# Autodesk Inventor assembly: sub
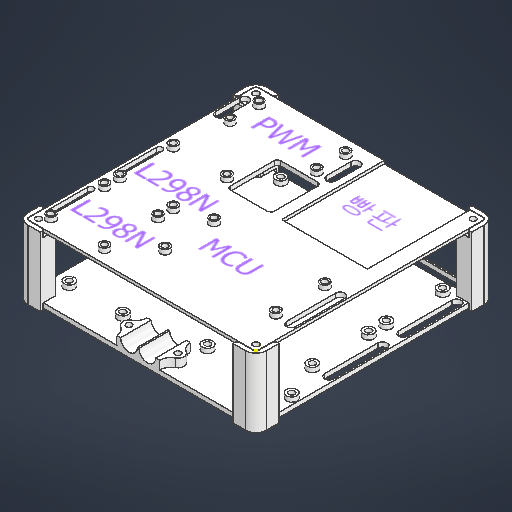
[picture p0: Inventor's stored thumbnail of the model, 512x512]
Saved by Autodesk Inventor 2026.2 (Build 302298010, 298A)
## iProperties
Created: 2026-04-29
Part Number: sub
Document SubType Name: Assembly
Designer: work
Author: work
## Documents named in this file (4)
- C:\Users\work\Desktop\ARD_v1\ARD_hardware\RA_Project\Substrate\sub.iam
- C:\Users\work\Desktop\ARD_v1\ARD_hardware\RA_Project\Substrate\Pillar.ipt
- C:\Users\work\Desktop\ARD_v1\ARD_hardware\RA_Project\Substrate\Power board.ipt
- C:\Users\work\Desktop\ARD_v1\ARD_hardware\RA_Project\Substrate\Control Board.ipt
## Components (6 placed, 3 different names)
1. Pillar:1 — 메이트:1, 메이트:2, 각도:1
2. Power board:1 — 메이트:1, 메이트:2, 각도:1, 메이트:3, 메이트:4, 메이트:5, 메이트:6, 메이트:7, 메이트:8, 각도:2, 각도:3, 각도:4
3. Control Board:1 — 메이트:9, 메이트:10, 메이트:11
4. Pillar:2 — 메이트:5, 메이트:6, 각도:3
5. Pillar:3 — 메이트:3, 메이트:8, 각도:4, 메이트:10, 메이트:11
6. Pillar:4 — 메이트:4, 메이트:7, 각도:2, 메이트:9
## Relationships (15: Mate 11, Angle 4)
- 메이트:1 [Mate]: Pillar:1 ↔ Power board:1
- 메이트:2 [Mate]: Pillar:1 ↔ Power board:1
- 각도:1 [Angle] (0 deg): Pillar:1 ↔ Power board:1
- 메이트:3 [Mate]: Power board:1 ↔ Pillar:3
- 메이트:4 [Mate]: Power board:1 ↔ Pillar:4
- 메이트:5 [Mate]: Power board:1 ↔ Pillar:2
- 메이트:6 [Mate]: Power board:1 ↔ Pillar:2
- 메이트:7 [Mate]: Power board:1 ↔ Pillar:4
- 메이트:8 [Mate]: Power board:1 ↔ Pillar:3
- 각도:2 [Angle] (0 deg): Power board:1 ↔ Pillar:4
- 각도:3 [Angle] (0 deg): Power board:1 ↔ Pillar:2
- 각도:4 [Angle] (0 deg): Power board:1 ↔ Pillar:3
- 메이트:9 [Mate]: Control Board:1 ↔ Pillar:4
- 메이트:10 [Mate]: Control Board:1 ↔ Pillar:3
- 메이트:11 [Mate]: Control Board:1 ↔ Pillar:3
